# Autodesk Inventor assembly: full_layout_test_v2
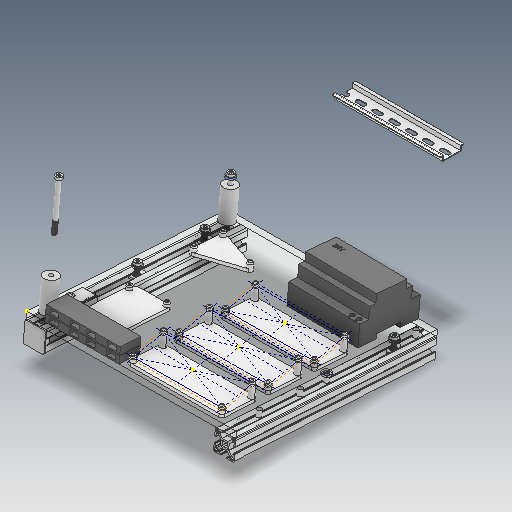
[picture p0: Inventor's stored thumbnail of the model, 512x512]
Saved by Autodesk Inventor 2025.4 (Build 294407020, 407B)
## iProperties
Created: 2026-09-08
Part Number: full_layout_test_v2
Document SubType Name: Assembly
Designer: Aiden
Author: Aiden
## Documents named in this file (17)
- C:\Users\Aiden\Documents\GitHub\coldex-instrumentation\3d_models\mounting_hardware\dummy_parts\full_layout_test_v2.iam
- C:\Users\Aiden\Documents\GitHub\coldex-instrumentation\3d_models\mounting_hardware\dummy_parts\acrylic_base.ipt
- C:\Users\Aiden\Documents\GitHub\coldex-instrumentation\3d_models\mounting_hardware\dummy_parts\acrylic_cover.ipt
- C:\Users\Aiden\Documents\GitHub\coldex-instrumentation\3d_models\mounting_hardware\McMaster\30mm_1ft_T-Slotted Framing.ipt
- C:\Users\Aiden\Documents\GitHub\coldex-instrumentation\3d_models\mounting_hardware\McMaster\30mm_teenut_T-Slotted Framing.ipt
- C:\Users\Aiden\Documents\GitHub\coldex-instrumentation\3d_models\mounting_hardware\McMaster\0.257in_innerD_Moisture-Resistant Cushioning Washer.ipt
- C:\Users\Aiden\Documents\GitHub\coldex-instrumentation\3d_models\mounting_hardware\McMaster\m6_18mm_18-8 Stainless Steel Low-Profile Socket Head Screws.ipt
- C:\Users\Aiden\Documents\GitHub\coldex-instrumentation\3d_models\mounting_hardware\dummy_parts\din_rail.ipt
- C:\Users\Aiden\Documents\GitHub\coldex-instrumentation\3d_models\mounting_hardware\dummy_parts\24V_din_pwr_supply.ipt
- C:\Users\Aiden\Documents\GitHub\coldex-instrumentation\3d_models\mounting_hardware\relay_module_standoffs_angled_plate.ipt
- C:\Users\Aiden\Documents\GitHub\coldex-instrumentation\3d_models\mounting_hardware\arduino_mega_standoffs_plate.ipt
- C:\Users\Aiden\Documents\GitHub\coldex-instrumentation\3d_models\mounting_hardware\dummy_parts\adalogger_mcu_volume.ipt
- C:\Users\Aiden\Documents\GitHub\coldex-instrumentation\3d_models\mounting_hardware\db-25_standoffs_plate.ipt
- C:\Users\Aiden\Documents\GitHub\coldex-instrumentation\3d_models\mounting_hardware\dummy_parts\anker_4-port_usb3.0_splitter.ipt
- C:\Users\Aiden\Documents\GitHub\coldex-instrumentation\3d_models\mounting_hardware\dummy_parts\spacer_temp.ipt
- C:\Users\Aiden\Documents\GitHub\coldex-instrumentation\3d_models\mounting_hardware\McMaster\m6_70mm_18-8 Stainless Steel Low-Profile Socket Head Screws.ipt
- C:\Users\Aiden\Documents\GitHub\coldex-instrumentation\3d_models\mounting_hardware\dummy_parts\8020_Cap.ipt
## Components (33 placed, 16 different names)
1. acrylic_base:1 — Flush:1, Flush:2, Mate:1, Mate:2, Flush:3, Flush:4, Mate:9, Mate:10, Mate:11, Mate:14, Mate:21, Mate:22, Mate:23, Mate:25, Mate:26, Mate:47, Angle:1, Mate:48, Angle:2, Angle:3, Mate:49, Mate:50, Angle:4, Mate:51, Flush:7, Mate:53, Mate:55, Mate:57, Mate:58, Flush:11, Mate:69
2. acrylic_cover:1 — Flush:1, Flush:2, Mate:61, Mate:62, Mate:63, Mate:67
3. 30mm_1ft_T-Slotted Framing:1 — Mate:1, Flush:4, Mate:3, Mate:4, Mate:5, Tangent:2, Flush:10
4. 30mm_1ft_T-Slotted Framing:2 — Mate:2, Flush:3, Mate:6, Flush:5, Flush:11
5. 30mm_teenut_T-Slotted Framing:1 — Mate:5, Mate:9
6. 30mm_teenut_T-Slotted Framing:2 — Mate:3, Mate:10
7. 30mm_teenut_T-Slotted Framing:3 — Mate:4, Mate:11, Tangent:2
8. 30mm_teenut_T-Slotted Framing:5 — Mate:6, Mate:14
9. m6_18mm_18-8 Stainless Steel Low-Profile Socket Head Screws:1 — Mate:35
10. m6_18mm_18-8 Stainless Steel Low-Profile Socket Head Screws:2 — Mate:34
11. m6_18mm_18-8 Stainless Steel Low-Profile Socket Head Screws:3
12. m6_18mm_18-8 Stainless Steel Low-Profile Socket Head Screws:4 — Mate:36
13. 0.257in_innerD_Moisture-Resistant Cushioning Washer:1 — Mate:22, Mate:34
14. 0.257in_innerD_Moisture-Resistant Cushioning Washer:2 — Mate:23, Mate:35
15. 0.257in_innerD_Moisture-Resistant Cushioning Washer:4 — Mate:26, Mate:36
16. 0.257in_innerD_Moisture-Resistant Cushioning Washer:5 — Mate:25
17. 0.257in_innerD_Moisture-Resistant Cushioning Washer:6 — Mate:21
18. arduino_mega_standoffs_plate:1 — Angle:3, Mate:49
19. adalogger_mcu_volume:1 — Mate:48, Angle:2
20. db-25_standoffs_plate:1 — Mate:50, Angle:4
21. anker_4-port_usb3.0_splitter:1 — Mate:51, Flush:7, Flush:8, Mate:52, Flush:9
22. anker_4-port_usb3.0_splitter:2 — Flush:8, Mate:52, Flush:9
23. spacer_temp:1 — Mate:53, Mate:58
24. spacer_temp:4 — Mate:55, Mate:57, Mate:61
25. m6_70mm_18-8 Stainless Steel Low-Profile Socket Head Screws:1 — Mate:62, Mate:66, Mate:68
26. m6_70mm_18-8 Stainless Steel Low-Profile Socket Head Screws:2 — Mate:63
27. 0.257in_innerD_Moisture-Resistant Cushioning Washer:7 — Mate:66, Mate:67, Mate:68
28. 8020_Cap:1 — Flush:10
29. din_rail:1
30. 24V_din_pwr_supply:1 — Mate:69
31. relay_module_standoffs_angled_plate:1 — Mate:47, Angle:1
32. relay_module_standoffs_angled_plate:2 — Flush:5
33. relay_module_standoffs_angled_plate:3
## Component patterns: (3 elements, first: relay_module_standoffs_angled_plate:1)
## Relationships (59: Mate 44, Flush 10, Angle 4, Tangent 1)
- Flush:1: acrylic_base:1 ↔ acrylic_cover:1
- Flush:2: acrylic_base:1 ↔ acrylic_cover:1
- Mate:1: acrylic_base:1 ↔ 30mm_1ft_T-Slotted Framing:1
- Mate:2: acrylic_base:1 ↔ 30mm_1ft_T-Slotted Framing:2
- Flush:3: acrylic_base:1 ↔ 30mm_1ft_T-Slotted Framing:2
- Flush:4: acrylic_base:1 ↔ 30mm_1ft_T-Slotted Framing:1
- Mate:3: 30mm_1ft_T-Slotted Framing:1 ↔ 30mm_teenut_T-Slotted Framing:2
- Mate:4: 30mm_1ft_T-Slotted Framing:1 ↔ 30mm_teenut_T-Slotted Framing:3
- Mate:5: 30mm_1ft_T-Slotted Framing:1 ↔ 30mm_teenut_T-Slotted Framing:1
- Mate:6: 30mm_1ft_T-Slotted Framing:2 ↔ 30mm_teenut_T-Slotted Framing:5
- Mate:9: acrylic_base:1 ↔ 30mm_teenut_T-Slotted Framing:1
- Mate:10: acrylic_base:1 ↔ 30mm_teenut_T-Slotted Framing:2
- Mate:11: acrylic_base:1 ↔ 30mm_teenut_T-Slotted Framing:3
- Mate:14: acrylic_base:1 ↔ 30mm_teenut_T-Slotted Framing:5
- Tangent:2: 30mm_1ft_T-Slotted Framing:1 ↔ 30mm_teenut_T-Slotted Framing:3
- [Mate]: acrylic_base:1 ↔ m6_18mm_18-8 Stainless Steel Low-Profile Socket Head Screws:1
- [Mate]: acrylic_base:1 ↔ m6_18mm_18-8 Stainless Steel Low-Profile Socket Head Screws:2
- [Mate]: acrylic_base:1 ↔ m6_18mm_18-8 Stainless Steel Low-Profile Socket Head Screws:3
- [Mate]: acrylic_base:1 ↔ m6_18mm_18-8 Stainless Steel Low-Profile Socket Head Screws:4
- Mate:21: acrylic_base:1 ↔ 0.257in_innerD_Moisture-Resistant Cushioning Washer:6
- Mate:22: acrylic_base:1 ↔ 0.257in_innerD_Moisture-Resistant Cushioning Washer:1
- Mate:23: acrylic_base:1 ↔ 0.257in_innerD_Moisture-Resistant Cushioning Washer:2
- Mate:25: acrylic_base:1 ↔ 0.257in_innerD_Moisture-Resistant Cushioning Washer:5
- Mate:26: acrylic_base:1 ↔ 0.257in_innerD_Moisture-Resistant Cushioning Washer:4
- [Mate]: m6_18mm_18-8 Stainless Steel Low-Profile Socket Head Screws:3 ↔ 0.257in_innerD_Moisture-Resistant Cushioning Washer:6
- [Mate]: m6_18mm_18-8 Stainless Steel Low-Profile Socket Head Screws:2 ↔ 0.257in_innerD_Moisture-Resistant Cushioning Washer:1
- [Mate]: m6_18mm_18-8 Stainless Steel Low-Profile Socket Head Screws:1 ↔ 0.257in_innerD_Moisture-Resistant Cushioning Washer:2
- [Mate]: m6_18mm_18-8 Stainless Steel Low-Profile Socket Head Screws:4 ↔ 0.257in_innerD_Moisture-Resistant Cushioning Washer:4
- [Mate]: m6_18mm_18-8 Stainless Steel Low-Profile Socket Head Screws:3 ↔ 0.257in_innerD_Moisture-Resistant Cushioning Washer:6
- Mate:34: m6_18mm_18-8 Stainless Steel Low-Profile Socket Head Screws:2 ↔ 0.257in_innerD_Moisture-Resistant Cushioning Washer:1
- Mate:35: m6_18mm_18-8 Stainless Steel Low-Profile Socket Head Screws:1 ↔ 0.257in_innerD_Moisture-Resistant Cushioning Washer:2
- Mate:36: m6_18mm_18-8 Stainless Steel Low-Profile Socket Head Screws:4 ↔ 0.257in_innerD_Moisture-Resistant Cushioning Washer:4
- Mate:47: acrylic_base:1 ↔ relay_module_standoffs_angled_plate:1
- Angle:1 (0 deg): acrylic_base:1 ↔ relay_module_standoffs_angled_plate:1
- Flush:5 (27 mm): 30mm_1ft_T-Slotted Framing:2 ↔ relay_module_standoffs_angled_plate:2
- Mate:48: acrylic_base:1 ↔ adalogger_mcu_volume:1
- Angle:2 (0 deg): acrylic_base:1 ↔ adalogger_mcu_volume:1
- Angle:3 (0 deg): acrylic_base:1 ↔ arduino_mega_standoffs_plate:1
- Mate:49: acrylic_base:1 ↔ arduino_mega_standoffs_plate:1
- Mate:50: acrylic_base:1 ↔ db-25_standoffs_plate:1
- Angle:4 (0 deg): acrylic_base:1 ↔ db-25_standoffs_plate:1
- Mate:51: acrylic_base:1 ↔ anker_4-port_usb3.0_splitter:1
- Flush:7: acrylic_base:1 ↔ anker_4-port_usb3.0_splitter:1
- Flush:8: anker_4-port_usb3.0_splitter:1 ↔ anker_4-port_usb3.0_splitter:2
- Mate:52 (1 mm): anker_4-port_usb3.0_splitter:1 ↔ anker_4-port_usb3.0_splitter:2
- Flush:9: anker_4-port_usb3.0_splitter:1 ↔ anker_4-port_usb3.0_splitter:2
- Mate:53: acrylic_base:1 ↔ spacer_temp:1
- Mate:55: acrylic_base:1 ↔ spacer_temp:4
- Mate:57: acrylic_base:1 ↔ spacer_temp:4
- Mate:58: acrylic_base:1 ↔ spacer_temp:1
- Mate:61: acrylic_cover:1 ↔ spacer_temp:4
- Mate:62: acrylic_cover:1 ↔ m6_70mm_18-8 Stainless Steel Low-Profile Socket Head Screws:1
- Mate:63: acrylic_cover:1 ↔ m6_70mm_18-8 Stainless Steel Low-Profile Socket Head Screws:2
- Mate:66: m6_70mm_18-8 Stainless Steel Low-Profile Socket Head Screws:1 ↔ 0.257in_innerD_Moisture-Resistant Cushioning Washer:7
- Mate:67: acrylic_cover:1 ↔ 0.257in_innerD_Moisture-Resistant Cushioning Washer:7
- Mate:68: m6_70mm_18-8 Stainless Steel Low-Profile Socket Head Screws:1 ↔ 0.257in_innerD_Moisture-Resistant Cushioning Washer:7
- Flush:10: 30mm_1ft_T-Slotted Framing:1 ↔ 8020_Cap:1
- Flush:11: acrylic_base:1 ↔ 30mm_1ft_T-Slotted Framing:2
- Mate:69: acrylic_base:1 ↔ 24V_din_pwr_supply:1
